# Autodesk Inventor assembly: ensamble5
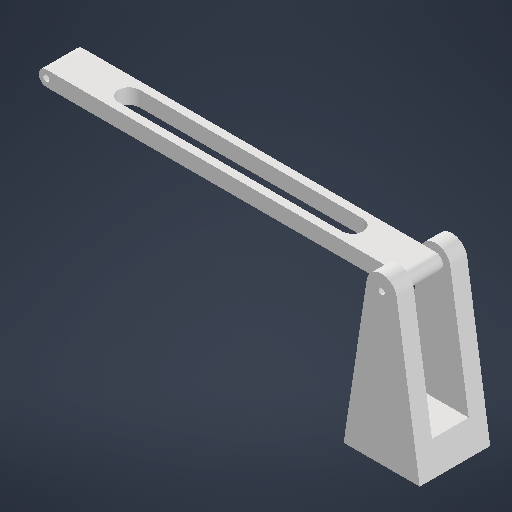
[picture p0: Inventor's stored thumbnail of the model, 512x512]
Saved by Autodesk Inventor 2027.1 (Build 311270010, 270A)
## iProperties
Created: 2026-11-07
Part Number: ensamble5
Document SubType Name: Assembly
Designer: MANGEL
Author: MANGEL
## Documents named in this file (3)
- C:\Users\MANGEL\Desktop\Brazo 4GL\ensamble5.iam
- C:\Users\MANGEL\Desktop\Brazo 4GL\barraBrazo2.ipt
- C:\Users\MANGEL\Desktop\Brazo 4GL\soporteBarrasBrazo.ipt
## Components (2 placed, 2 different names)
1. barraBrazo2:1 — Insertar:1
2. soporteBarrasBrazo:1 — Insertar:1
## Relationships (1: Insert 1)
- Insertar:1: barraBrazo2:1 ↔ soporteBarrasBrazo:1
